# Autodesk Inventor assembly: MM0948AN120_G03_800
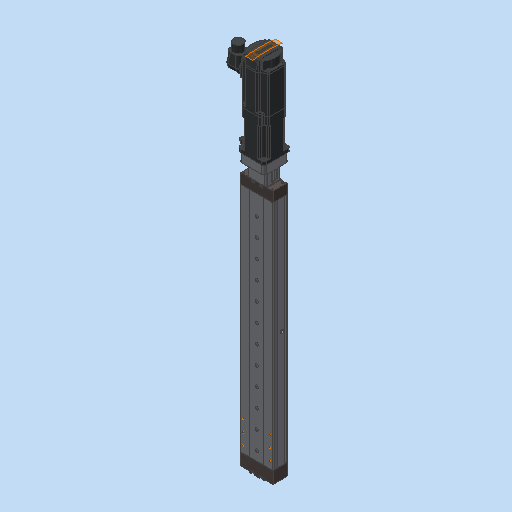
[picture p0: Inventor's stored thumbnail of the model, 512x512]
Saved by Autodesk Inventor 2023.3 (Build 273359000, 359)
## iProperties
Part Number: MM0948AN120_G03_800
Material: Generisch
Description: =<RBPARTNOTITLE2>
Document SubType Name: Assembly
Designer: ric7an
Mass: 1207.87 g
Surface Area: 3153.9 cm^2
Volume: 1207.87 cm^3
Density: 1 g/cm^3
Created: 2023-03-27
RBCHANGEDESCRIPTION1: Erstfreigabe
RBCHANGENO1: 00
RBDOCUMENTTYPE: DRF
RBDOCUMENTVERSION: 00
RBDRAWINGMAINSCALE: 1:1
RBDRAWINGMISSINGSPEC: --
RBDRAWINGVOLUME: --
RBDSV1: 0850
RBGBDETAILS: 43274
RBGBEDGESIN1: +0,5
RBGBEDGESIN2: +0,2
RBGBEDGESOUT1: -0,3
RBGBEDGESOUT2: -0,1
RBMATERIAL: =<Material>
RBMATMEETS: --
RBMATNO: =<Part Number>
RBORGUNITRESPONSIBLE1: AnP/TEF1
RBPARTMADEOF: CKK070 mit Motor, siehe Zeichnung
RBPARTNO: SIEHE MNR
RBPARTNOTITLE1: spindle axis CKK 070
RBPARTNOTITLE2: Spindelachse CKK 070
RBPARTSAFETYINDICATOR: --
RBSURFACE: --
RBSURFACE2: --
RBZEDGESNORM: ISO13715:2002-06
RBZGENDIMCLASS: m
RBZGENDIMNORM: ISO 2768-1:1989-11
RBZGENGEOCLASS: H
RBZGENGEONORM: ISO 2768-2:1989-11
RBZSURFACENORM: ISO13D2:2002-02
RBZTOLERANCENORM: ISO 14405-1:2010-12
AnP_Kommentar: --
MaxAbmaße: --
AnP_TemplVers: 20190222
AnP_Kategorie: 11
AnP_Material: =<Material>
RBGBREMARKSINDEX: E
Author: ric7an
Keywords: =<RBPARTMADEOF>
Comments: =<RBSURFACE2>
Revision Number: 01
## Documents named in this file (4)
- C:\Users\rea9an\Documents\Inventor\TCAI2412_te1910_EM\AS00000945.iam
- C:\Users\rea9an\Documents\Inventor\TCAI2412_te1910_EM\PT00004642.ipt
- C:\Users\rea9an\Documents\Inventor\TCAI2412_te1910_EM\PT00004643.ipt
- C:\Users\rea9an\Documents\Inventor\DispenserPackGo\MM0948AN120_G03_800.iam
## Components (2 placed, 2 different names)
1. PT00004642:1 — Passend:1, Fluchtend:2, Winkel:1
2. PT00004643:1 — Passend:1, Fluchtend:2, Winkel:1
## Relationships (3: Mate 1, Flush 1, Angle 1)
- Passend:1 [Mate]: PT00004642:1 ↔ PT00004643:1
- Fluchtend:2 [Flush] (441 mm): PT00004642:1 ↔ PT00004643:1
- Winkel:1 [Angle] (0 deg): PT00004642:1 ↔ PT00004643:1
